# Autodesk Inventor assembly: MM0948AN170_G00_817
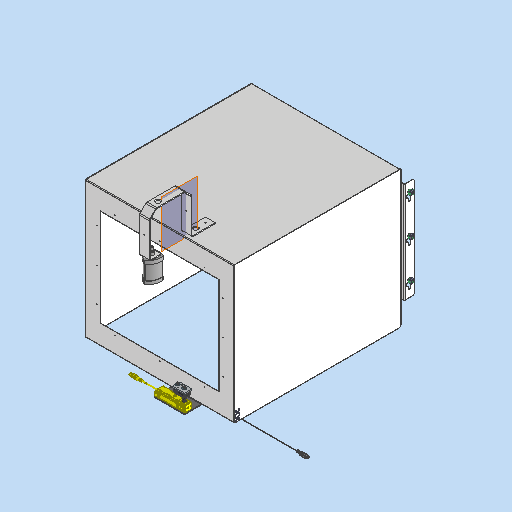
[picture p0: Inventor's stored thumbnail of the model, 512x512]
Saved by Autodesk Inventor 2023.3 (Build 273359000, 359)
## iProperties
Created: 2023-03-23
Part Number: MM0948AN170_G00_817
Description: =<RBPARTNOTITLE2>
Document SubType Name: Assembly
Designer: FH/Wi
Mass: 19380.9 g
Surface Area: 32977.3 cm^2
Volume: 3011.23 cm^3
Density: 6.43623 g/cm^3
AnP_Kategorie: 98
AnP_Material: =<Material>
AnP_TemplVers: 20200821
RBDOCUMENTTYPE: DRF
RBDOCUMENTVERSION: 00
RBDRAWINGMAINSCALE: 1:1
RBDRAWINGMISSINGSPEC: --
RBDRAWINGVOLUME: --
RBDSV1: 0850
RBGBEDGESIN1: +0,5
RBGBEDGESIN2: +0,2
RBGBEDGESOUT1: -0,3
RBGBEDGESOUT2: -0,1
RBMATERIAL: =<Material>
RBMATMEETS: --
RBMATNO: =<Part Number>
RBPARTMADEOF: --
RBPARTNO: SIEHE MNR
RBPARTNOTITLE1: enter description here
RBPARTNOTITLE2: hier Bezeichnung eintragen
RBPARTSAFETYINDICATOR: --
RBSURFACE: --
RBSURFACE2: --
RBZEDGESNORM: ISO13715:2002-06
RBZGENDIMCLASS: m
RBZGENDIMNORM: ISO 2768-1:1989-11
RBZGENGEOCLASS: H
RBZGENGEONORM: ISO 2768-2:1989-11
RBZSURFACENORM: ISO13D2:2002-02
RBZTOLERANCENORM: ISO 14405-1:2010-12
Author: FH/Wi
Keywords: =<RBPARTMADEOF>
Comments: =<RBSURFACE2>
Revision Number: 01
## Documents named in this file (9)
- C:\Users\rea9an\Documents\Inventor\TCAI2412_te1910_EM\AS00000968.iam
- C:\Users\rea9an\Documents\Inventor\TCAI2412_te1910_EM\PT00004799.ipt
- C:\Users\rea9an\Documents\Inventor\TCAI2412_te1910_EM\PT00004359.ipt
- C:\Users\rea9an\Documents\Inventor\TCAI2412_te1910_EM\PT00004480.ipt
- C:\Users\rea9an\Documents\Inventor\TCAI2412_te1910_EM\PT00004311.ipt
- C:\Users\rea9an\Documents\Inventor\TCAI2412_te1910_EM\PT00004347.ipt
- C:\Users\rea9an\Documents\Inventor\TCAI2412_te1910_EM\AS00000899.iam
- C:\Users\rea9an\Documents\Inventor\TCAI2412_te1910_EM\AS00000922.iam
- C:\Users\rea9an\Documents\Inventor\TCAI2412_te1910_EM\PT00004708.ipt
## Components (22 placed, 8 different names)
1. PT00004708:1 — Fluchtend:7, Fluchtend:8, Fluchtend:9, Passend:18
2. PT00004799:1 — Passend:18
3. AS00000899:1 [sub-assembly] — Fluchtend:13
4. AS00000922:1 [sub-assembly] — Passend:17, Fluchtend:14, Fluchtend:15
5. PT00004359:1
6. PT00004347:1 — Fluchtend:13, Passend:17, Fluchtend:14, Fluchtend:15
7. PT00004480:1
8. PT00004311:1
9. PT00004480:2
10. PT00004311:2
11. PT00004480:3
12. PT00004311:3
13. PT00004480:4
14. PT00004311:4
15. PT00004480:5
16. PT00004311:5
17. PT00004480:6
18. PT00004311:6
19. PT00004480:7
20. PT00004311:7
21. PT00004480:8
22. PT00004311:8
## Relationships (33: Insert 17, Mate 8, Flush 8)
- [Mate]: PT00004708:1 ↔ PT00004799:1
- [Mate]: PT00004799:1 ↔ PT00004359:1
- [Insert]: PT00004799:1 ↔ PT00004359:1
- [Flush] (-10 mm): PT00004708:1 ↔ PT00004799:1
- [Mate]: PT00004708:1 ↔ PT00004347:1
- [Mate]: PT00004708:1 ↔ PT00004347:1
- [Flush]: PT00004708:1 ↔ PT00004347:1
- [Insert] (5 mm): PT00004480:1 ↔ PT00004311:1
- [Insert]: PT00004708:1 ↔ PT00004480:1
- [Insert] (5 mm): PT00004480:2 ↔ PT00004311:2
- [Insert] (5 mm): PT00004480:3 ↔ PT00004311:3
- [Insert] (5 mm): PT00004480:4 ↔ PT00004311:4
- [Insert]: PT00004708:1 ↔ PT00004480:2
- [Insert]: PT00004708:1 ↔ PT00004480:3
- [Insert]: PT00004708:1 ↔ PT00004480:4
- [Insert] (5 mm): PT00004480:5 ↔ PT00004311:5
- [Insert]: PT00004708:1 ↔ PT00004480:5
- [Insert] (5 mm): PT00004480:6 ↔ PT00004311:6
- [Insert]: PT00004708:1 ↔ PT00004480:6
- [Insert] (5 mm): PT00004480:7 ↔ PT00004311:7
- [Insert] (5 mm): PT00004480:8 ↔ PT00004311:8
- [Insert]: PT00004708:1 ↔ PT00004480:8
- [Insert]: PT00004708:1 ↔ PT00004480:7
- Fluchtend:7 [Flush] (307.5 mm): PT00004708:1
- Fluchtend:8 [Flush] (957 mm): PT00004708:1
- Fluchtend:9 [Flush] (-2650 mm): PT00004708:1
- [Mate]: AS00000899:1 ↔ PT00004347:1
- [Mate] (-40 mm): AS00000899:1 ↔ PT00004347:1
- Fluchtend:13 [Flush] (64 mm): AS00000899:1 ↔ PT00004347:1
- Passend:17 [Mate]: AS00000922:1 ↔ PT00004347:1
- Fluchtend:14 [Flush] (-25.5 mm): AS00000922:1 ↔ PT00004347:1
- Fluchtend:15 [Flush] (156 mm): AS00000922:1 ↔ PT00004347:1
- Passend:18 [Mate]: PT00004708:1 ↔ PT00004799:1
## Named parameters: d206_d39_d725_d707 = 5 mm, d207_d39_d725_d707 = 5 mm, d213_d39_d725_d707 = 5 mm, d217_d39_d725_d707 = 5 mm, d219_d39_d725_d707 = 5 mm, d220_d39_d725_d707 = 5 mm, d203_d39_d725_d707 = 5 mm, d205_d39_d725_d707 = 5 mm
